# Autodesk Inventor assembly: penguin
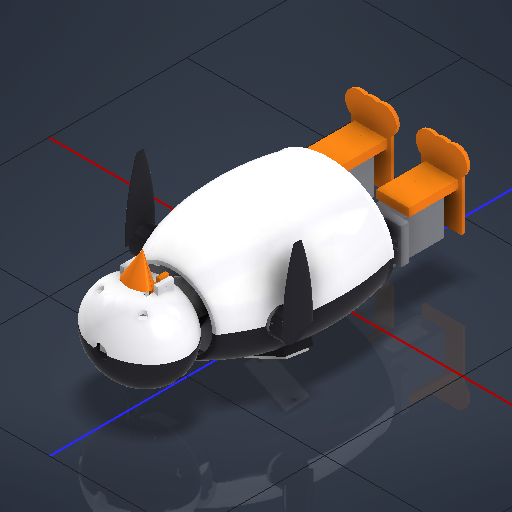
[picture p0: Inventor's stored thumbnail of the model, 512x512]
Saved by Autodesk Inventor 2027.1 (Build 311270010, 270A)
## iProperties
Created: 2026-10-28
Part Number: penguin
Document SubType Name: Assembly
Designer: shyan
Mass: 579.701 g
Surface Area: 2334.82 cm^2
Volume: 409.483 cm^3
Density: 1.41569 g/cm^3
Author: shyan
## Documents named in this file (25)
- C:\Users\shyan\OneDrive - University of Bath\Year 4\Projects\Penguin\CAD\penguin.iam
- C:\Users\shyan\OneDrive - University of Bath\Year 4\Projects\Penguin\CAD\dummies\servo_mg90s_dummy.ipt
- C:\Users\shyan\OneDrive - University of Bath\Year 4\Projects\Penguin\CAD\dummies\dummy_battery_holder.ipt
- C:\Users\shyan\OneDrive - University of Bath\Year 4\Projects\Penguin\CAD\dummies\dummy_protoboard.ipt
- C:\Users\shyan\OneDrive - University of Bath\Year 4\Projects\Penguin\CAD\dummies\dummy_esp32.ipt
- C:\Users\shyan\OneDrive - University of Bath\Year 4\Projects\Penguin\CAD\dummies\dummy_buck.ipt
- C:\Users\shyan\OneDrive - University of Bath\Year 4\Projects\Penguin\CAD\dummies\dummy_switch.ipt
- C:\Users\shyan\OneDrive - University of Bath\Year 4\Projects\Penguin\CAD\dummies\dummy_usb_socket.ipt
- C:\Users\shyan\OneDrive - University of Bath\Year 4\Projects\Penguin\CAD\base_plate.ipt
- C:\Users\shyan\OneDrive - University of Bath\Year 4\Projects\Penguin\CAD\core_frame.ipt
- C:\Users\shyan\OneDrive - University of Bath\Year 4\Projects\Penguin\CAD\body_front.ipt
- C:\Users\shyan\OneDrive - University of Bath\Year 4\Projects\Penguin\CAD\body_back.ipt
- C:\Users\shyan\OneDrive - University of Bath\Year 4\Projects\Penguin\CAD\head_front.ipt
- C:\Users\shyan\OneDrive - University of Bath\Year 4\Projects\Penguin\CAD\head_back.ipt
- C:\Users\shyan\OneDrive - University of Bath\Year 4\Projects\Penguin\CAD\leg_R.ipt
- C:\Users\shyan\OneDrive - University of Bath\Year 4\Projects\Penguin\CAD\leg_L.ipt
- C:\Users\shyan\OneDrive - University of Bath\Year 4\Projects\Penguin\CAD\foot_R.ipt
- C:\Users\shyan\OneDrive - University of Bath\Year 4\Projects\Penguin\CAD\foot_L.ipt
- C:\Users\shyan\OneDrive - University of Bath\Year 4\Projects\Penguin\CAD\flipper_R.ipt
- C:\Users\shyan\OneDrive - University of Bath\Year 4\Projects\Penguin\CAD\flipper_L.ipt
- C:\Users\shyan\OneDrive - University of Bath\Year 4\Projects\Penguin\CAD\beak_upper.ipt
- C:\Users\shyan\OneDrive - University of Bath\Year 4\Projects\Penguin\CAD\beak_lower.ipt
- C:\Users\shyan\OneDrive - University of Bath\Year 4\Projects\Penguin\CAD\dummies\dummy_speaker23.ipt
- C:\Users\shyan\OneDrive - University of Bath\Year 4\Projects\Penguin\CAD\dummies\dummy_i2s_mic.ipt
- C:\Users\shyan\OneDrive - University of Bath\Year 4\Projects\Penguin\CAD\penguin_params.xlsx
## Components (29 placed, 29 different names)
1. SERVO_HIP_R — SERVO_HIP_R_X, SERVO_HIP_R_Y, SERVO_HIP_R_Z
2. SERVO_HIP_L — SERVO_HIP_L_X, SERVO_HIP_L_Y, SERVO_HIP_L_Z
3. SERVO_FLIP_R
4. SERVO_FLIP_L
5. SERVO_ANKLE_R — svankR_m1, svankR_f2, svankR_f3
6. SERVO_ANKLE_L — svankL_m1, svankL_f2, svankL_f3
7. BATTERY
8. PROTOBOARD
9. ESP32
10. BUCK
11. SWITCH
12. USB
13. BASE_PLATE — BASE_YZ, BASE_XZ, BASE_XY, hipR_axis, hipR_slide, hipR_angle, hipL_axis, hipL_slide, hipL_angle
14. CORE_FRAME — FRAME_YZ, FRAME_XZ, FRAME_XY, flipR_axis, flipR_slide, flipR_angle, flipL_axis, flipL_slide, flipL_angle
15. BODY_FRONT — BODY_FRONT_YZ, BODY_FRONT_XZ, BODY_FRONT_XY
16. BODY_BACK — BODY_BACK_YZ, BODY_BACK_XZ, BODY_BACK_XY
17. HEAD_FRONT — HEAD_FRONT_YZ, HEAD_FRONT_XZ, HEAD_FRONT_XY, beak_axis, beak_slide, beak_angle
18. HEAD_BACK — HEAD_BACK_YZ, HEAD_BACK_XZ, HEAD_BACK_XY
19. LEG_R — svankR_m1, svankR_f2, svankR_f3, hipR_axis, hipR_slide, hipR_angle, ankR_axis, ankR_slide, ankR_angle
20. LEG_L — svankL_m1, svankL_f2, svankL_f3, hipL_axis, hipL_slide, hipL_angle, ankL_axis, ankL_slide, ankL_angle
21. FOOT_R — ankR_axis, ankR_slide, ankR_angle
22. FOOT_L — ankL_axis, ankL_slide, ankL_angle
23. FLIPPER_R — flipR_axis, flipR_slide, flipR_angle
24. FLIPPER_L — flipL_axis, flipL_slide, flipL_angle
25. BEAK_UPPER — Flush:34, Flush:35, Flush:36
26. BEAK_LOWER — beak_axis, beak_slide, beak_angle
27. SERVO_BEAK
28. SPEAKER
29. MIC
## Relationships (54: Flush 27, Mate 20, Angle 7)
- BASE_YZ [Flush]: BASE_PLATE
- BASE_XZ [Flush]: BASE_PLATE
- BASE_XY [Flush]: BASE_PLATE
- SERVO_HIP_R_X [Mate] (26 mm): SERVO_HIP_R
- SERVO_HIP_R_Y [Flush]: SERVO_HIP_R
- SERVO_HIP_R_Z [Mate] (15.5 mm): SERVO_HIP_R
- SERVO_HIP_L_X [Mate] (-26 mm): SERVO_HIP_L
- SERVO_HIP_L_Y [Flush]: SERVO_HIP_L
- SERVO_HIP_L_Z [Mate] (15.5 mm): SERVO_HIP_L
- FRAME_YZ [Flush]: CORE_FRAME
- FRAME_XZ [Flush]: CORE_FRAME
- FRAME_XY [Flush]: CORE_FRAME
- BODY_FRONT_YZ [Flush]: BODY_FRONT
- BODY_FRONT_XZ [Flush]: BODY_FRONT
- BODY_FRONT_XY [Flush]: BODY_FRONT
- BODY_BACK_YZ [Flush]: BODY_BACK
- BODY_BACK_XZ [Flush]: BODY_BACK
- BODY_BACK_XY [Flush]: BODY_BACK
- HEAD_FRONT_YZ [Flush]: HEAD_FRONT
- HEAD_FRONT_XZ [Flush]: HEAD_FRONT
- HEAD_FRONT_XY [Flush]: HEAD_FRONT
- HEAD_BACK_YZ [Flush]: HEAD_BACK
- HEAD_BACK_XZ [Flush]: HEAD_BACK
- HEAD_BACK_XY [Flush]: HEAD_BACK
- svankR_m1 [Mate] (26 mm): SERVO_ANKLE_R ↔ LEG_R
- svankR_f2 [Flush] (40 mm): SERVO_ANKLE_R ↔ LEG_R
- svankR_f3 [Flush] (16.7 mm): SERVO_ANKLE_R ↔ LEG_R
- svankL_m1 [Mate] (-26 mm): SERVO_ANKLE_L ↔ LEG_L
- svankL_f2 [Flush] (40 mm): SERVO_ANKLE_L ↔ LEG_L
- svankL_f3 [Flush] (16.7 mm): SERVO_ANKLE_L ↔ LEG_L
- Flush:34: BEAK_UPPER
- Flush:35: BEAK_UPPER
- Flush:36: BEAK_UPPER
- hipR_axis [Mate]: BASE_PLATE ↔ LEG_R
- hipR_slide [Mate]: BASE_PLATE ↔ LEG_R
- hipR_angle [Angle] (0 deg): BASE_PLATE ↔ LEG_R
- hipL_axis [Mate]: BASE_PLATE ↔ LEG_L
- hipL_slide [Mate]: BASE_PLATE ↔ LEG_L
- hipL_angle [Angle] (0 deg): BASE_PLATE ↔ LEG_L
- ankR_axis [Mate]: LEG_R ↔ FOOT_R
- ankR_slide [Mate]: LEG_R ↔ FOOT_R
- ankR_angle [Angle] (0 deg): LEG_R ↔ FOOT_R
- ankL_axis [Mate]: LEG_L ↔ FOOT_L
- ankL_slide [Mate]: LEG_L ↔ FOOT_L
- ankL_angle [Angle] (0 deg): LEG_L ↔ FOOT_L
- flipR_axis [Mate]: CORE_FRAME ↔ FLIPPER_R
- flipR_slide [Mate]: CORE_FRAME ↔ FLIPPER_R
- flipR_angle [Angle] (0 deg): CORE_FRAME ↔ FLIPPER_R
- flipL_axis [Mate]: CORE_FRAME ↔ FLIPPER_L
- flipL_slide [Mate]: CORE_FRAME ↔ FLIPPER_L
- flipL_angle [Angle] (0 deg): CORE_FRAME ↔ FLIPPER_L
- beak_axis [Mate]: HEAD_FRONT ↔ BEAK_LOWER
- beak_slide [Mate]: HEAD_FRONT ↔ BEAK_LOWER
- beak_angle [Angle] (0 deg): HEAD_FRONT ↔ BEAK_LOWER
## Named parameters: sv_tabZ = 15.5 mm, hip_x = 26 mm, clr = 0.3 mm, wall = 2.4 mm, sv_L = 22.8 mm, sv_W = 12.2 mm, sv_H = 22.7 mm, sv_full = 28.5 mm, sv_tab = 32.5 mm, sv_tabT = 2.5 mm, sv_pitch = 27.5 mm, sv_shaft = 5.9 mm, sv_dome = 12 mm, sv_domeH = 3.3 mm, sv_spline = 4.8 mm, m2_pilot = 1.7 mm, horn_len = 31.5 mm, horn_hub = 7.2 mm, horn_tip = 4.5 mm, horn_T = 1.8 mm, horn_hubH = 3.8 mm, ins_d = 4 mm, ins_L = 6 mm, m3 = 3.4 mm, nut_af = 5.8 mm, plate_T = 5 mm, col_H = 16 mm, tray_T = 3 mm, bodyW0 = 96 mm, bodyD0 = 80 mm, bodyW35 = 106 mm, bodyD35 = 86 mm, bodyW85 = 92 mm, bodyD85 = 74 mm, bodyW112 = 64 mm, bodyD112 = 56 mm, Z_sec1 = 35 mm, Z_sec2 = 85 mm, Z_sec3 = 112 mm, Z_flip = 78 mm, Z_bridge = 98 mm, bat_W = 77 mm, bat_D = 41 mm, bat_H = 21 mm, esp_W = 55 mm, esp_D = 28 mm, esp_H = 13 mm, pcb_W = 60 mm, pcb_D = 38 mm, pcb_T = 1.6 mm, bk_W = 30 mm, bk_D = 22 mm, bk_H = 10 mm, df_W = 49 mm, df_D = 32 mm, df_H = 12 mm, sw_W = 21 mm, sw_D = 15 mm, sw_H = 25 mm, usb_cut_W = 12 mm, usb_cut_H = 7 mm, usb_pitch = 28 mm, hip_ang_R = 0 deg, hip_ang_L = 0 deg, ank_ang_R = 0 deg, ank_ang_L = 0 deg, flip_ang_R = 0 deg, flip_ang_L = 0 deg, beak_ang = 0 deg, Z_ankle = -40 mm, sv_ank_Y = -16.7 mm
